# Autodesk Inventor assembly: VFD_ASSY
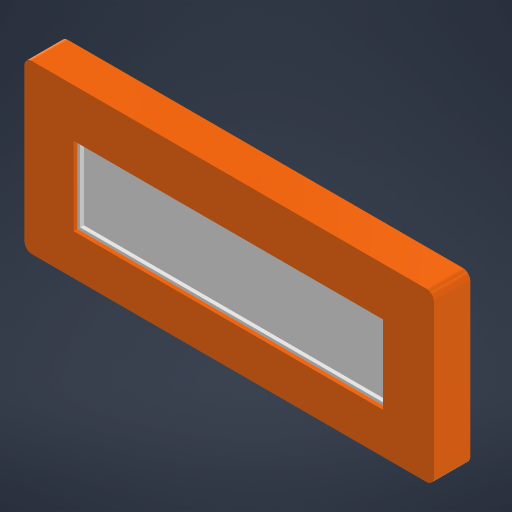
[picture p0: Inventor's stored thumbnail of the model, 512x512]
Saved by Autodesk Inventor 2024.3 (Build 283343000, 343)
## iProperties
Created: 2026-11-11
Part Number: VFD_ASSY
Document SubType Name: Assembly
Designer: REMOTE
Author: REMOTE
## Documents named in this file (3)
- C:\Users\REMOTE\Desktop\FUTABA_VFD_3D\VFD_ASSY.iam
- C:\Users\REMOTE\Desktop\FUTABA_VFD_3D\VDF.ipt
- C:\Users\REMOTE\Desktop\FUTABA_VFD_3D\VFD_FRONT.ipt
## Components (2 placed, 2 different names)
1. VDF:1 — Flush:1
2. VFD_FRONT:1 — Flush:1
## Relationships (1: Flush 1)
- Flush:1: VDF:1 ↔ VFD_FRONT:1
